# Autodesk Inventor assembly: robotfish_new_1
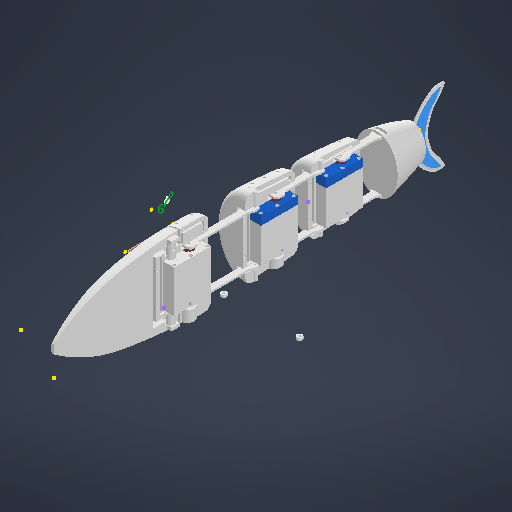
[picture p0: Inventor's stored thumbnail of the model, 512x512]
Saved by Autodesk Inventor 2027 (Build 310192060, 192F)
## iProperties
Created: 2026-08-23
Part Number: robotfish_new_1
Document SubType Name: Assembly
Designer: thita
Sending System: Autodesk Inventor 2027
Preprocessor: ST-DEVELOPER v20.1
Title: robotfish_newest.stp
Author: Laptop
## iProperties of the stored document tail.ipt
Created: 2026-08-23
Part Number: tail
Material: Generic
Document SubType Name: Modeling
Designer: thita
Density: 1 g/cm^3
Appearance: Default
Sending System: Autodesk Inventor 2027
Preprocessor: ST-DEVELOPER v20.1
Title: tail.stp
Author: thita
## Documents named in this file (27)
- C:\Users\thita\ROBOT CÁ\robotfish_newest\robotfish_newest.iam
- C:\Users\thita\ROBOT CÁ\robotfish_newest\segment2.ipt
- C:\Users\thita\ROBOT CÁ\robotfish_newest\segment3.ipt
- C:\Users\thita\ROBOT CÁ\robotfish_newest\thanh lk.ipt
- C:\Users\thita\ROBOT CÁ\robotfish_newest\thanh lk 1.ipt
- C:\Users\thita\ROBOT CÁ\robotfish_newest\manh_tren_truc_2.ipt
- C:\Users\thita\ROBOT CÁ\robotfish_newest\manh_tren_truc_3.ipt
- C:\Users\thita\ROBOT CÁ\robotfish_newest\segment1.ipt
- C:\Users\thita\ROBOT CÁ\robotfish_newest\head.ipt
- C:\Users\thita\ROBOT CÁ\robotfish_newest\truc_khop_3_MIR.ipt
- C:\Users\thita\ROBOT CÁ\robotfish_newest\Bearing 684-2Z (STEP AP214).ipt
- C:\Users\thita\ROBOT CÁ\robotfish_newest\thanhlk 3.ipt
- C:\Users\thita\ROBOT CÁ\robotfish_newest\hop v3.iam
- C:\Users\thita\ROBOT CÁ\robotfish_newest\thanh lk 4.ipt
- C:\Users\thita\ROBOT CÁ\robotfish_newest\thanhlk 5.ipt
- C:\Users\thita\ROBOT CÁ\robotfish_newest\Assembly1.iam
- C:\Users\thita\ROBOT CÁ\ROBOTFISH_FINAL2\robotfish_new\Workgroups\NotInProject\thanh lk 2.ipt
- C:\Users\thita\Downloads\vây đuôi phương án A.ipt
- **C:\Users\thita\ROBOT CÁ\robotfish_newest\robotfish_newest.iam*LocalDocs*xAaaaa3daAaaaaaaaAaaaqbifZb*tail.ipt
- C:\Users\thita\ROBOT CÁ\robotfish_newest\mieng_lap_segment1.ipt
- C:\Users\thita\ROBOT CÁ\robotfish_newest\mieng_lap_tren_segment2.ipt
- C:\Users\thita\ROBOT CÁ\robotfish_newest\mieng_lap_truoc_duoi_segmen2.ipt
- C:\Users\thita\ROBOT CÁ\robotfish_newest\mieng_lap_sau_duoi_segment2.ipt
- C:\Users\thita\ROBOT CÁ\robotfish_newest\mieng_lap_truoc_duoi_segment3.ipt
- C:\Users\thita\ROBOT CÁ\robotfish_newest\mieng_lap_tren_segment3.ipt
- C:\Users\thita\ROBOT CÁ\robotfish_newest\mieng_lap_sau_duoi_segment3.ipt
- C:\Users\thita\Downloads\tail.stp
## Components (27 placed, 25 different names)
1. segment2:1 — Rotational:2
2. segment3:1
3. thanh lk:1
4. thanh lk 1:1
5. manh_tren_truc_2:1
6. manh_tren_truc_3:1
7. segment1:1 — Rotational:1, Flush:1
8. head:1
9. truc_khop_3_MIR:1
10. Bearing 684-2Z (STEP AP214):1
11. Bearing 684-2Z (STEP AP214):2
12. thanhlk 3:1 — Rotational:1
13. hop v3:13 [sub-assembly]
14. hop v3:14 [sub-assembly] — Rigid:1
15. thanh lk 4:1 — Rotational:2
16. thanhlk 5:1
17. Assembly1:17 [sub-assembly] — Flush:1
18. thanh lk 2:1 — Rigid:1, Rigid:2
19. vây đuôi phương án A:1
20. tail:2 — Rigid:2
21. mieng_lap_segment1:1
22. mieng_lap_tren_segment2:1
23. mieng_lap_truoc_duoi_segmen2:1
24. mieng_lap_sau_duoi_segment2:1
25. mieng_lap_truoc_duoi_segment3:1
26. mieng_lap_tren_segment3:1
27. mieng_lap_sau_duoi_segment3:1
## Relationships (5: RevoluteJoint 2, WeldJoint 2, Flush 1)
- Rotational:1 [RevoluteJoint]: segment1:1 ↔ thanhlk 3:1
- Rotational:2 [RevoluteJoint]: segment2:1 ↔ thanh lk 4:1
- Rigid:1 [WeldJoint]: hop v3:14 ↔ thanh lk 2:1
- Rigid:2 [WeldJoint]: thanh lk 2:1 ↔ tail:2
- Flush:1 (-70 mm): segment1:1 ↔ Assembly1:17
